# Autodesk Inventor assembly: p1-p2-v3
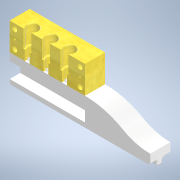
[picture p0: Inventor's stored thumbnail of the model, 180x180]
Saved by Autodesk Inventor 2020 (Build 240168000, 168)
## iProperties
Created: 2022-06-16
Part Number: p1-p2-v3
Document SubType Name: Assembly
Designer: drago
Author: drago
## Documents named in this file (3)
- C:\Users\drago\Documents\ULTIMA_VARIANTA\Assembly\p1-p2-v3.iam
- C:\Users\drago\Documents\ULTIMA_VARIANTA\Broasca\Broascav3\P2_V3_001.ipt
- C:\Users\drago\Documents\ULTIMA_VARIANTA\Suporti Cuie\Suport Cuie Varianta 3 + PDF pt DAN sa faca cheile - Copy (3)\P1_V3_001.ipt
## Components (2 placed, 2 different names)
1. P2_V3_001:1 — Mate:1, Flush:1, Flush:2
2. P1_V3_001:1 — Mate:1, Flush:1, Flush:2
## Relationships (3: Flush 2, Mate 1)
- Mate:1: P2_V3_001:1 ↔ P1_V3_001:1
- Flush:1: P2_V3_001:1 ↔ P1_V3_001:1
- Flush:2: P2_V3_001:1 ↔ P1_V3_001:1
